# Autodesk Inventor assembly: Track and coil spools
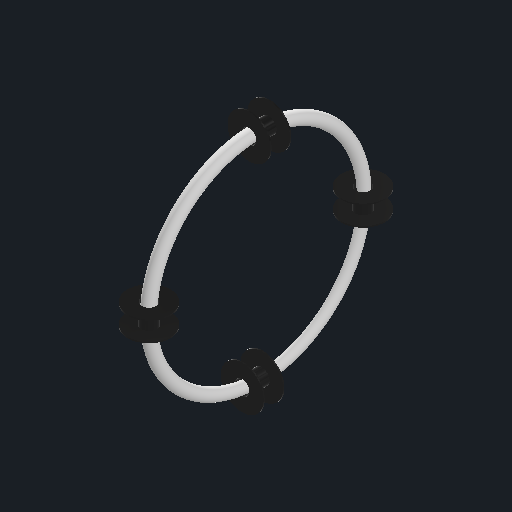
[picture p0: Inventor's stored thumbnail of the model, 512x512]
Saved by Autodesk Inventor 2026.2 (Build 302298010, 298A)
## iProperties
Created: 2026-10-05
Part Number: Track and coil spools
Document SubType Name: Assembly
Designer: denis
Mass: 144.034 g
Surface Area: 1629.84 cm^2
Volume: 144.034 cm^3
Density: 1 g/cm^3
Author: denis
## Documents named in this file (3)
- C:\Users\denis\OneDrive\Documents\Inventor\Particle Accelerator Model\CAD\Track and coil spools.iam
- C:\Users\denis\OneDrive\Documents\Inventor\Particle Accelerator Model\Coil spool.ipt
- C:\Users\denis\OneDrive\Documents\Inventor\Particle Accelerator Model\Track segment.ipt
## Components (8 placed, 2 different names)
1. Spulenhalterung:1
2. Bahn:1
3. Spulenhalterung:2
4. Bahn:2
5. Spulenhalterung:3
6. Bahn:3
7. Spulenhalterung:4
8. Bahn:4
## Component patterns: (4 elements, first: Spulenhalterung:1 + Bahn:1)
